# Autodesk Inventor assembly: Assembly_servo_neck
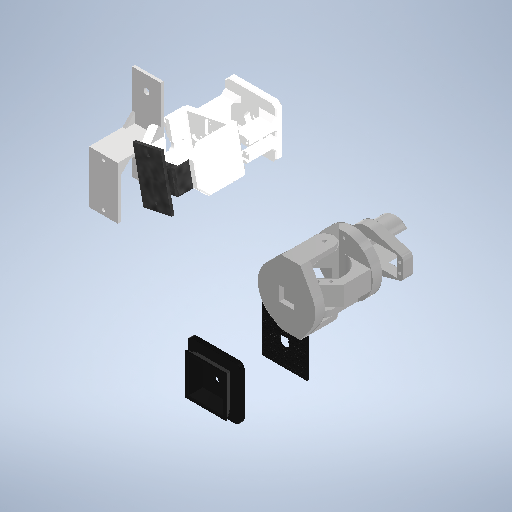
[picture p0: Inventor's stored thumbnail of the model, 512x512]
Saved by Autodesk Inventor 2025 (Build 290162000, 162)
## iProperties
Created: 2026-11-08
Part Number: Assembly_servo_neck
Document SubType Name: Assembly
Designer: diego
Author: diego
## Documents named in this file (10)
- D:\Diego\Proyectos_Diego\Halloween Hackathon\Halloween-Hackathon\CAD\Assembly_servo_neck.iam
- D:\Diego\Proyectos_Diego\Halloween Hackathon\Halloween-Hackathon\CAD\out\obj_1_装配体1 - 底座-1.STL.ipt
- D:\Diego\Proyectos_Diego\Halloween Hackathon\Halloween-Hackathon\CAD\out\obj_2_装配体1 - 二级-1.STL.ipt
- D:\Diego\Proyectos_Diego\Halloween Hackathon\Halloween-Hackathon\CAD\out\obj_3_装配体1 - trst-1-1.STL.ipt
- D:\Diego\Proyectos_Diego\Halloween Hackathon\Halloween-Hackathon\CAD\out\2 Axis Lower Mount.ipt
- D:\Diego\Proyectos_Diego\Halloween Hackathon\Halloween-Hackathon\CAD\out\2 Axis Mid Mount.ipt
- D:\Diego\Proyectos_Diego\Halloween Hackathon\Halloween-Hackathon\CAD\out\2 Axis Upper Mount.ipt
- D:\Diego\Proyectos_Diego\Halloween Hackathon\Halloween-Hackathon\CAD\3Dprint\Skull_base.ipt
- D:\Diego\Proyectos_Diego\Halloween Hackathon\Halloween-Hackathon\CAD\out\Quick+Release+Plate+-+Part1.ipt
- D:\Diego\Proyectos_Diego\Halloween Hackathon\Halloween-Hackathon\CAD\out\Quick+Release+Plate+-+Part2.ipt
## Components (9 placed, 9 different names)
1. obj_1_装配体1 - 底座-1.STL:1 — Mate:5, Mate:7
2. obj_2_装配体1 - 二级-1.STL:1 — Mate:6, Angle:1
3. obj_3_装配体1 - trst-1-1.STL:1 — Mate:5, Mate:6, Mate:7, Angle:1
4. 2 Axis Lower Mount:1
5. 2 Axis Mid Mount:1 — Mate:1, Mate:2
6. 2 Axis Upper Mount:1 — Mate:1, Mate:2
7. Skull_base:1
8. Quick+Release+Plate+-+Part1:1
9. Quick+Release+Plate+-+Part2:1
## Relationships (6: Mate 5, Angle 1)
- Mate:1: 2 Axis Mid Mount:1 ↔ 2 Axis Upper Mount:1
- Mate:2: 2 Axis Mid Mount:1 ↔ 2 Axis Upper Mount:1
- Mate:5 (4 mm): obj_1_装配体1 - 底座-1.STL:1 ↔ obj_3_装配体1 - trst-1-1.STL:1
- Mate:6: obj_2_装配体1 - 二级-1.STL:1 ↔ obj_3_装配体1 - trst-1-1.STL:1
- Mate:7: obj_1_装配体1 - 底座-1.STL:1 ↔ obj_3_装配体1 - trst-1-1.STL:1
- Angle:1 (180 deg): obj_2_装配体1 - 二级-1.STL:1 ↔ obj_3_装配体1 - trst-1-1.STL:1
